# Autodesk Inventor assembly: MM0948AN100_G60_801
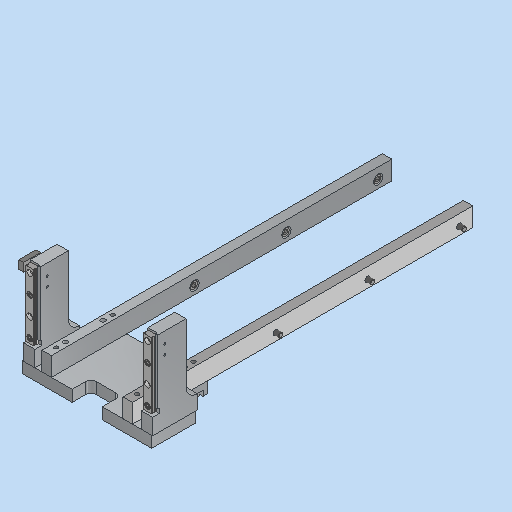
[picture p0: Inventor's stored thumbnail of the model, 512x512]
Saved by Autodesk Inventor 2023.3 (Build 273359000, 359)
## iProperties
RuleStatus: InUse
Created: 2023-03-23
Part Number: MM0948AN100_G60_801
Description: =<RBPARTNOTITLE2>
Document SubType Name: Assembly
Designer: FH/Wi
Mass: 915.259 g
Surface Area: 1084.63 cm^2
Volume: 324.777 cm^3
Density: 2.81811 g/cm^3
AnP_Kategorie: 98
AnP_Material: =<Material>
AnP_TemplVers: 20200821
RBDOCUMENTTYPE: DRF
RBDOCUMENTVERSION: 00
RBDRAWINGMAINSCALE: 1:1
RBDRAWINGMISSINGSPEC: --
RBDRAWINGVOLUME: --
RBDSV1: 0850
RBGBEDGESIN1: +0,5
RBGBEDGESIN2: +0,2
RBGBEDGESOUT1: -0,3
RBGBEDGESOUT2: -0,1
RBMATERIAL: =<Material>
RBMATMEETS: --
RBMATNO: =<Part Number>
RBPARTMADEOF: --
RBPARTNO: SIEHE MNR
RBPARTNOTITLE1: enter description here
RBPARTNOTITLE2: hier Bezeichnung eintragen
RBPARTSAFETYINDICATOR: --
RBSURFACE: --
RBSURFACE2: --
RBZEDGESNORM: ISO13715:2002-06
RBZGENDIMCLASS: m
RBZGENDIMNORM: ISO 2768-1:1989-11
RBZGENGEOCLASS: H
RBZGENGEONORM: ISO 2768-2:1989-11
RBZSURFACENORM: ISO13D2:2002-02
RBZTOLERANCENORM: ISO 14405-1:2010-12
Author: FH/Wi
Keywords: =<RBPARTMADEOF>
Comments: =<RBSURFACE2>
Revision Number: 01
## Documents named in this file (14)
- C:\Users\rea9an\Documents\Inventor\TCAI2412_te1910_EM\AS00000940.iam
- C:\Users\rea9an\Documents\Inventor\TCAI2412_te1910_EM\PT00004594.ipt
- C:\Users\rea9an\Documents\Inventor\TCAI2412_te1910_EM\PT00004593.ipt
- C:\Users\rea9an\Documents\Inventor\TCAI2412_te1910_EM\PT00004595.ipt
- C:\Users\rea9an\Documents\Inventor\TCAI2412_te1910_EM\PT00004599.ipt
- C:\Users\rea9an\Documents\Inventor\TCAI2412_te1910_EM\PT00004452.ipt
- C:\Users\rea9an\Documents\Inventor\TCAI2412_te1910_EM\PT00004876.ipt
- C:\Users\rea9an\Documents\Inventor\TCAI2412_te1910_EM\PT00004867.ipt
- C:\Users\rea9an\Documents\Inventor\TCAI2412_te1910_EM\PT00004914.ipt
- C:\Users\rea9an\Documents\Inventor\TCAI2412_te1910_EM\PT00004877.ipt
- C:\Users\rea9an\Documents\Inventor\TCAI2412_te1910_EM\PT00004917.ipt
- C:\Users\rea9an\Documents\Inventor\TCAI2412_te1910_EM\PT00004600.ipt
- C:\Users\rea9an\Documents\Inventor\TCAI2412_te1910_EM\PT00004830.ipt
- C:\Users\rea9an\Documents\Inventor\TCAI2412_te1910_EM\PT00004865.ipt
## Components (34 placed, 13 different names)
1. PT00004594:1
2. PT00004593:1
3. PT00004595:1
4. PT00004599:1
5. PT00004599:2
6. PT00004600:1
7. PT00004452:1 — Einfügen:28, Einfügen:29
8. PT00004452:2 — Einfügen:26, Einfügen:27
9. PT00004865:1 — Einfügen:26
10. PT00004865:2 — Einfügen:27
11. PT00004865:3 — Einfügen:29
12. PT00004865:4 — Einfügen:28
13. PT00004830:2
14. PT00004830:1
15. PT00004876:1
16. PT00004876:2
17. PT00004876:3
18. PT00004876:4
19. PT00004876:5
20. PT00004876:6
21. PT00004877:3
22. PT00004877:1
23. PT00004914:1
24. PT00004867:4
25. PT00004914:2
26. PT00004867:1
27. PT00004917:1
28. PT00004914:3
29. PT00004867:3
30. PT00004877:2
31. PT00004867:2
32. PT00004914:4
33. PT00004877:4
34. PT00004917:2
## Relationships (41: Insert 29, Mate 10, Flush 2)
- [Mate]: PT00004594:1 ↔ PT00004593:1
- [Mate]: PT00004594:1 ↔ PT00004593:1
- [Mate]: PT00004594:1 ↔ PT00004595:1
- [Insert]: PT00004594:1 ↔ PT00004599:2
- [Insert]: PT00004594:1 ↔ PT00004599:1
- [Mate]: PT00004594:1 ↔ PT00004599:1
- [Mate]: PT00004594:1 ↔ PT00004599:2
- [Insert]: PT00004599:1 ↔ PT00004452:1
- [Insert]: PT00004599:2 ↔ PT00004452:2
- [Mate]: PT00004599:2 ↔ PT00004452:2
- [Mate]: PT00004599:1 ↔ PT00004452:1
- [Insert]: PT00004595:1 ↔ PT00004876:5
- [Insert]: PT00004595:1 ↔ PT00004876:1
- [Insert]: PT00004595:1 ↔ PT00004876:2
- [Insert]: PT00004593:1 ↔ PT00004876:4
- [Insert]: PT00004593:1 ↔ PT00004876:3
- [Insert]: PT00004593:1 ↔ PT00004876:6
- [Flush]: PT00004593:1 ↔ PT00004595:1
- [Flush]: PT00004593:1 ↔ PT00004595:1
- [Insert]: PT00004594:1 ↔ PT00004867:1
- [Insert]: PT00004594:1 ↔ PT00004867:4
- [Insert]: PT00004594:1 ↔ PT00004867:3
- [Insert]: PT00004594:1 ↔ PT00004867:2
- [Insert] (8 mm): PT00004594:1 ↔ PT00004914:3
- [Insert] (8 mm): PT00004594:1 ↔ PT00004914:4
- [Insert] (-8 mm): PT00004594:1 ↔ PT00004914:2
- [Insert] (-8 mm): PT00004594:1 ↔ PT00004914:1
- [Insert]: PT00004594:1 ↔ PT00004877:1
- [Insert]: PT00004594:1 ↔ PT00004877:2
- [Insert]: PT00004594:1 ↔ PT00004877:3
- [Insert] (-8 mm): PT00004594:1 ↔ PT00004917:1
- [Insert]: PT00004594:1 ↔ PT00004877:4
- [Insert] (-8 mm): PT00004594:1 ↔ PT00004917:2
- [Mate]: PT00004600:1 ↔ PT00004830:2
- [Mate]: PT00004600:1 ↔ PT00004830:1
- [Insert]: PT00004599:2 ↔ PT00004600:1
- [Mate]: PT00004599:2 ↔ PT00004600:1
- Einfügen:26 [Insert]: PT00004452:2 ↔ PT00004865:1
- Einfügen:27 [Insert]: PT00004452:2 ↔ PT00004865:2
- Einfügen:28 [Insert]: PT00004452:1 ↔ PT00004865:4
- Einfügen:29 [Insert]: PT00004452:1 ↔ PT00004865:3
